# Autodesk Inventor assembly: ASSEMBLY_DUT_Ant_Rotator
(part 3 of 3)
- Mate:295: 3DP_PLA_Fiberglass_Pipe_Corner_Bracket_Clamp:3 ↔ COTS_DREMEC_8G206M6X50_M6x50_Nylon_Screw:20
- Mate:296: 3DP_PLA_Fiberglass_Pipe_Corner_Bracket_Clamp:3 ↔ COTS_DREMEC_8G206M6X50_M6x50_Nylon_Screw:19
- Mate:297: 3DP_PLA_Fiberglass_Pipe_Corner_Bracket_Clamp:3 ↔ COTS_DREMEC_8G206M6X50_M6x50_Nylon_Screw:23
- Mate:298: 3DP_PLA_Fiberglass_Pipe_Corner_Bracket_Clamp:3 ↔ COTS_DREMEC_8G206M6X50_M6x50_Nylon_Screw:21
- Mate:299: 3DP_PLA_Fiberglass_Pipe_Corner_Bracket_Clamp:3 ↔ COTS_DREMEC_8G206M6X50_M6x50_Nylon_Screw:24
- Mate:300: 3DP_PLA_Fiberglass_Pipe_Corner_Bracket_Clamp:2 ↔ COTS_DREMEC_8G206M6X50_M6x50_Nylon_Screw:17
- Mate:301: 3DP_PLA_Fiberglass_Pipe_Corner_Bracket_Clamp:2 ↔ COTS_DREMEC_8G206M6X50_M6x50_Nylon_Screw:18
- Mate:302: 3DP_PLA_Fiberglass_Pipe_Corner_Bracket_Clamp:2 ↔ COTS_DREMEC_8G206M6X50_M6x50_Nylon_Screw:16
- Mate:303: 3DP_PLA_Fiberglass_Pipe_Corner_Bracket_Clamp:2 ↔ COTS_DREMEC_8G206M6X50_M6x50_Nylon_Screw:14
- Mate:304: 3DP_PLA_Fiberglass_Pipe_Corner_Bracket_Clamp:2 ↔ COTS_DREMEC_8G206M6X50_M6x50_Nylon_Screw:13
- Mate:305: 3DP_PLA_Fiberglass_Pipe_Corner_Bracket_Clamp:2 ↔ COTS_DREMEC_8G206M6X50_M6x50_Nylon_Screw:15
- Mate:306: 3DP_PLA_Fiberglass_Pipe_Corner_Bracket:2 ↔ COTS_BOSSARD_1400444_M6_Nylon_Nut:13
- Mate:307: 3DP_PLA_Fiberglass_Pipe_Corner_Bracket:2 ↔ COTS_BOSSARD_1400444_M6_Nylon_Nut:14
- Mate:308: 3DP_PLA_Fiberglass_Pipe_Corner_Bracket:2 ↔ COTS_BOSSARD_1400444_M6_Nylon_Nut:18
- Mate:309: 3DP_PLA_Fiberglass_Pipe_Corner_Bracket:2 ↔ COTS_BOSSARD_1400444_M6_Nylon_Nut:16
- Mate:310: 3DP_PLA_Fiberglass_Pipe_Corner_Bracket:2 ↔ COTS_BOSSARD_1400444_M6_Nylon_Nut:17
- Mate:311: 3DP_PLA_Fiberglass_Pipe_Corner_Bracket:2 ↔ COTS_BOSSARD_1400444_M6_Nylon_Nut:15
- Mate:312: 3DP_PLA_Fiberglass_Pipe_Corner_Bracket:2 ↔ COTS_BOSSARD_1400444_M6_Nylon_Nut:19
- Mate:313: 3DP_PLA_Fiberglass_Pipe_Corner_Bracket:2 ↔ COTS_BOSSARD_1400444_M6_Nylon_Nut:20
- Mate:314: 3DP_PLA_Fiberglass_Pipe_Corner_Bracket:2 ↔ COTS_BOSSARD_1400444_M6_Nylon_Nut:21
- Mate:315: 3DP_PLA_Fiberglass_Pipe_Corner_Bracket:2 ↔ COTS_BOSSARD_1400444_M6_Nylon_Nut:22
- Mate:316: 3DP_PLA_Fiberglass_Pipe_Corner_Bracket:2 ↔ COTS_BOSSARD_1400444_M6_Nylon_Nut:23
- Mate:317: 3DP_PLA_Fiberglass_Pipe_Corner_Bracket:2 ↔ COTS_BOSSARD_1400444_M6_Nylon_Nut:24
- Mate:318: COTS_BOSSARD_1400444_M6_Nylon_Nut:14 ↔ COTS_DREMEC_8G206M6X50_M6x50_Nylon_Screw:17
- Mate:319: COTS_BOSSARD_1400444_M6_Nylon_Nut:13 ↔ COTS_DREMEC_8G206M6X50_M6x50_Nylon_Screw:15
- Mate:320: COTS_BOSSARD_1400444_M6_Nylon_Nut:15 ↔ COTS_DREMEC_8G206M6X50_M6x50_Nylon_Screw:18
- Mate:321: COTS_BOSSARD_1400444_M6_Nylon_Nut:18 ↔ COTS_DREMEC_8G206M6X50_M6x50_Nylon_Screw:16
- Mate:322: COTS_BOSSARD_1400444_M6_Nylon_Nut:17 ↔ COTS_DREMEC_8G206M6X50_M6x50_Nylon_Screw:14
- Mate:323: COTS_BOSSARD_1400444_M6_Nylon_Nut:16 ↔ COTS_DREMEC_8G206M6X50_M6x50_Nylon_Screw:13
- Mate:324: COTS_BOSSARD_1400444_M6_Nylon_Nut:19 ↔ COTS_DREMEC_8G206M6X50_M6x50_Nylon_Screw:24
- Mate:325: COTS_BOSSARD_1400444_M6_Nylon_Nut:20 ↔ COTS_DREMEC_8G206M6X50_M6x50_Nylon_Screw:19
- Mate:326: COTS_BOSSARD_1400444_M6_Nylon_Nut:22 ↔ COTS_DREMEC_8G206M6X50_M6x50_Nylon_Screw:20
- Mate:327: COTS_BOSSARD_1400444_M6_Nylon_Nut:21 ↔ COTS_DREMEC_8G206M6X50_M6x50_Nylon_Screw:23
- Mate:328: COTS_BOSSARD_1400444_M6_Nylon_Nut:24 ↔ COTS_DREMEC_8G206M6X50_M6x50_Nylon_Screw:21
- Mate:329: COTS_BOSSARD_1400444_M6_Nylon_Nut:23 ↔ COTS_DREMEC_8G206M6X50_M6x50_Nylon_Screw:22
- Mate:331: 3DP_PLA_Fiberglass_Pipe_Corner_Bracket_Clamp_and_B_axis_Stepper_Mount:1 ↔ ASSEMBLY_HTD3M_Idler_B_Axis:1
- Mate:332: 3DP_PLA_Fiberglass_Pipe_Corner_Bracket_Clamp_and_B_axis_Stepper_Mount:1 ↔ ASSEMBLY_HTD3M_Idler_B_Axis:2
- Mate:333: 3DP_PLA_Fiberglass_Pipe_Corner_Bracket_Clamp_and_B_axis_Stepper_Mount:1 ↔ ASSEMBLY_HTD3M_Idler_B_Axis:2
- Mate:334: 3DP_PLA_Fiberglass_Pipe_Corner_Bracket_Clamp_and_B_axis_Stepper_Mount:1 ↔ ASSEMBLY_HTD3M_Idler_B_Axis:1
- Mate:335: COTS_GENERIC_HTD3M_20T_6mm_5mm_shaft_pulley:1 ↔ COTS_GENERIC_HTD3M_6mm_1530mm_Closed_belt_B_Axis:1
- Mate:336 (6 mm): 3DP_PLA_Fiberglass_Pipe_Corner_Bracket_Clamp_and_B_axis_Stepper_Mount:1 ↔ COTS_MKS_SERVO42D_40mm:2
- Mate:337 (0.5 mm): COTS_GENERIC_HTD3M_20T_6mm_5mm_shaft_pulley:1 ↔ COTS_GENERIC_HTD3M_6mm_1530mm_Closed_belt_B_Axis:1
- Mate:339: 3DP_PLA_B_Axis_Main_Pulley:1 ↔ COTS_GENERIC_HTD3M_6mm_1530mm_Closed_belt_B_Axis:1
- Mate:340 (0.5 mm): 3DP_PLA_B_Axis_Main_Pulley:1 ↔ COTS_GENERIC_HTD3M_6mm_1530mm_Closed_belt_B_Axis:1
- Mate:341: COTS_MKS_SERVO42D_40mm:2 ↔ DIN 125-1 A A 3,2:5
- Mate:342: 3DP_PLA_Fiberglass_Pipe_Corner_Bracket_Clamp_and_B_axis_Stepper_Mount:1 ↔ DIN 125-1 A A 3,2:5
- Mate:343: COTS_MKS_SERVO42D_40mm:2 ↔ DIN 125-1 A A 3,2:6
- Mate:344: 3DP_PLA_Fiberglass_Pipe_Corner_Bracket_Clamp_and_B_axis_Stepper_Mount:1 ↔ DIN 125-1 A A 3,2:6
- Mate:345: COTS_MKS_SERVO42D_40mm:2 ↔ DIN 125-1 A A 3,2:7
- Mate:346: 3DP_PLA_Fiberglass_Pipe_Corner_Bracket_Clamp_and_B_axis_Stepper_Mount:1 ↔ DIN 125-1 A A 3,2:7
- Mate:347: COTS_MKS_SERVO42D_40mm:2 ↔ DIN 125-1 A A 3,2:8
- Mate:348: 3DP_PLA_Fiberglass_Pipe_Corner_Bracket_Clamp_and_B_axis_Stepper_Mount:1 ↔ DIN 125-1 A A 3,2:8
- Insert:5: ISO 7380-1 M3 x 16:5 ↔ DIN 125-1 A A 3,2:5
- Insert:6: ISO 7380-1 M3 x 16:6 ↔ DIN 125-1 A A 3,2:6
- Insert:7: ISO 7380-1 M3 x 16:7 ↔ DIN 125-1 A A 3,2:7
- Insert:8: ISO 7380-1 M3 x 16:8 ↔ DIN 125-1 A A 3,2:8
- Angle:42 (90 deg): COTS_CARBONCENTER_Fiberglass_Tube_27x24x383mm:3 ↔ COTS_GENERIC_HTD3M_6mm_1530mm_Closed_belt_B_Axis:1
- Mate:357: 3DP_PLA_B_Axis_Main_Pulley:1 ↔ COTS_GENERIC_6016_80x125x22mm_POM_Ball_Bearing:1
- Mate:358: 3DP_PLA_B_Axis_Main_Pulley:1 ↔ COTS_GENERIC_6016_80x125x22mm_POM_Ball_Bearing:1
- Mate:359: 3DP_PLA_B_Axis_Main_Pulley:1 ↔ COTS_GENERIC_6016_80x125x22mm_POM_Ball_Bearing:2
- Mate:360: 3DP_PLA_B_Axis_Main_Pulley:1 ↔ COTS_GENERIC_6016_80x125x22mm_POM_Ball_Bearing:2
- Mate:361: COTS_GENERIC_6016_80x125x22mm_POM_Ball_Bearing:2 ↔ 3DP_PLA_B_Axis_Bearing_Mounting_Plate:1
- Flush:16: COTS_GENERIC_6016_80x125x22mm_POM_Ball_Bearing:2 ↔ 3DP_PLA_B_Axis_Bearing_Mounting_Plate:1
- Angle:43 (0 deg): 3DP_PLA_Fiberglass_Pipe_Corner_Bracket_Clamp_and_B_axis_Stepper_Mount:1 ↔ 3DP_PLA_B_Axis_Bearing_Mounting_Plate:1
- Flush:17: COTS_GENERIC_6016_80x125x22mm_POM_Ball_Bearing:1 ↔ 3DP_PLA_B_Axis_Bearing_Mounting_Plate:2
- Mate:362: COTS_GENERIC_6016_80x125x22mm_POM_Ball_Bearing:1 ↔ 3DP_PLA_B_Axis_Bearing_Mounting_Plate:2
- Flush:18: 3DP_PLA_B_Axis_Bearing_Mounting_Plate:1 ↔ 3DP_PLA_B_Axis_Bearing_Mounting_Plate:2
- Mate:363: 3DP_PLA_B_Axis_Bearing_Mounting_Plate:1 ↔ ASSEMBLY_HTD3M_Idler_B_Axis_Top:1
- Mate:364: 3DP_PLA_B_Axis_Bearing_Mounting_Plate:1 ↔ ASSEMBLY_HTD3M_Idler_B_Axis_Top:2
- Mate:365: 3DP_PLA_B_Axis_Bearing_Mounting_Plate:1 ↔ ASSEMBLY_HTD3M_Idler_B_Axis_Top:1
- Mate:366: 3DP_PLA_B_Axis_Bearing_Mounting_Plate:1 ↔ ASSEMBLY_HTD3M_Idler_B_Axis_Top:2
- Mate:367: 3DP_PLA_B_Axis_Bearing_Mounting_Plate:1 ↔ COTS_DREMEC_8G206V50126_M4x40_Screw:1
- Mate:368: 3DP_PLA_B_Axis_Bearing_Mounting_Plate:1 ↔ COTS_DREMEC_8G206V50126_M4x40_Screw:2
- Mate:369: 3DP_PLA_B_Axis_Bearing_Mounting_Plate:1 ↔ COTS_DREMEC_8G206V50126_M4x40_Screw:2
- Mate:370: 3DP_PLA_B_Axis_Bearing_Mounting_Plate:1 ↔ COTS_DREMEC_8G206V50126_M4x40_Screw:1
- Mate:371: 3DP_PLA_B_Axis_Bearing_Mounting_Plate:2 ↔ COTS_DREMEC_8G206M6X50_M6x50_Nylon_Screw:25
- Mate:372: 3DP_PLA_B_Axis_Bearing_Mounting_Plate:2 ↔ COTS_DREMEC_8G206M6X50_M6x50_Nylon_Screw:26
- Mate:373: 3DP_PLA_B_Axis_Bearing_Mounting_Plate:2 ↔ COTS_DREMEC_8G206M6X50_M6x50_Nylon_Screw:27
- Mate:374: 3DP_PLA_B_Axis_Bearing_Mounting_Plate:2 ↔ COTS_DREMEC_8G206M6X50_M6x50_Nylon_Screw:28
- Mate:375: 3DP_PLA_B_Axis_Bearing_Mounting_Plate:2 ↔ COTS_DREMEC_8G206M6X50_M6x50_Nylon_Screw:29
- Mate:376: 3DP_PLA_B_Axis_Bearing_Mounting_Plate:2 ↔ COTS_DREMEC_8G206M6X50_M6x50_Nylon_Screw:30
- Mate:377: 3DP_PLA_B_Axis_Bearing_Mounting_Plate:2 ↔ COTS_DREMEC_8G206M6X50_M6x50_Nylon_Screw:26
- Mate:378: 3DP_PLA_B_Axis_Bearing_Mounting_Plate:2 ↔ COTS_DREMEC_8G206M6X50_M6x50_Nylon_Screw:28
- Mate:379: 3DP_PLA_B_Axis_Bearing_Mounting_Plate:2 ↔ COTS_DREMEC_8G206M6X50_M6x50_Nylon_Screw:30
- Mate:380: 3DP_PLA_B_Axis_Bearing_Mounting_Plate:2 ↔ COTS_DREMEC_8G206M6X50_M6x50_Nylon_Screw:27
- Mate:381: 3DP_PLA_B_Axis_Bearing_Mounting_Plate:2 ↔ COTS_DREMEC_8G206M6X50_M6x50_Nylon_Screw:25
- Mate:382: 3DP_PLA_B_Axis_Bearing_Mounting_Plate:2 ↔ COTS_DREMEC_8G206M6X50_M6x50_Nylon_Screw:29
- Mate:383: 3DP_PLA_B_Axis_Bearing_Mounting_Plate:1 ↔ COTS_BOSSARD_1400444_M6_Nylon_Nut:25
- Mate:384: 3DP_PLA_B_Axis_Bearing_Mounting_Plate:1 ↔ COTS_BOSSARD_1400444_M6_Nylon_Nut:27
- Mate:385: 3DP_PLA_B_Axis_Bearing_Mounting_Plate:1 ↔ COTS_BOSSARD_1400444_M6_Nylon_Nut:29
- Mate:386: 3DP_PLA_B_Axis_Bearing_Mounting_Plate:1 ↔ COTS_BOSSARD_1400444_M6_Nylon_Nut:30
- Mate:387: 3DP_PLA_B_Axis_Bearing_Mounting_Plate:1 ↔ COTS_BOSSARD_1400444_M6_Nylon_Nut:28
- Mate:388: 3DP_PLA_B_Axis_Bearing_Mounting_Plate:1 ↔ COTS_BOSSARD_1400444_M6_Nylon_Nut:26
- Mate:389: COTS_BOSSARD_1400444_M6_Nylon_Nut:25 ↔ COTS_DREMEC_8G206M6X50_M6x50_Nylon_Screw:28
- Mate:390: COTS_BOSSARD_1400444_M6_Nylon_Nut:28 ↔ COTS_DREMEC_8G206M6X50_M6x50_Nylon_Screw:26
- Mate:391: COTS_BOSSARD_1400444_M6_Nylon_Nut:27 ↔ COTS_DREMEC_8G206M6X50_M6x50_Nylon_Screw:27
- Mate:392: COTS_BOSSARD_1400444_M6_Nylon_Nut:30 ↔ COTS_DREMEC_8G206M6X50_M6x50_Nylon_Screw:30
- Mate:393: COTS_BOSSARD_1400444_M6_Nylon_Nut:29 ↔ COTS_DREMEC_8G206M6X50_M6x50_Nylon_Screw:25
- Mate:394: COTS_BOSSARD_1400444_M6_Nylon_Nut:26 ↔ COTS_DREMEC_8G206M6X50_M6x50_Nylon_Screw:29
- Mate:395: 3DP_PLA_B_Axis_Bearing_Mounting_Plate:2 ↔ COTS_DREMEC_8G206M6X50_M6x50_Nylon_Screw:31
- Mate:396: 3DP_PLA_B_Axis_Bearing_Mounting_Plate:2 ↔ COTS_DREMEC_8G206M6X50_M6x50_Nylon_Screw:31
- Mate:397: 3DP_PLA_B_Axis_Bearing_Mounting_Plate:1 ↔ COTS_BOSSARD_1400444_M6_Nylon_Nut:31
- Mate:398: COTS_BOSSARD_1400444_M6_Nylon_Nut:31 ↔ COTS_DREMEC_8G206M6X50_M6x50_Nylon_Screw:31
- Mate:399: 3DP_PLA_B_Axis_Bearing_Mounting_Plate:2 ↔ COTS_BOSSARD_1400428_M4_Nylon_Nut:1
- Mate:400: 3DP_PLA_B_Axis_Bearing_Mounting_Plate:2 ↔ COTS_BOSSARD_1400428_M4_Nylon_Nut:2
- Mate:401: COTS_BOSSARD_1400428_M4_Nylon_Nut:1 ↔ COTS_DREMEC_8G206V50126_M4x40_Screw:1
- Mate:402: COTS_BOSSARD_1400428_M4_Nylon_Nut:2 ↔ COTS_DREMEC_8G206V50126_M4x40_Screw:2
- Mate:403: COTS_GENERIC_6016_80x125x22mm_POM_Ball_Bearing:2 ↔ 3DP_PLA_B_Axis_Rotating_Stage:1
- Mate:404: 3DP_PLA_B_Axis_Main_Pulley:1 ↔ 3DP_PLA_B_Axis_Rotating_Stage:1
- Mate:405: COTS_CARBONCENTER_Fiberglass_Tube_27x24x383mm:6 ↔ 3DP_PLA_B_Axis_Rotating_Stage:1
- Mate:406: COTS_CARBONCENTER_Fiberglass_Tube_27x24x383mm:5 ↔ 3DP_PLA_B_Axis_Rotating_Stage:1
- Flush:19: COTS_CARBONCENTER_Fiberglass_Tube_27x24x383mm:5 ↔ 3DP_PLA_B_Axis_Rotating_Stage:1
- Mate:407: COTS_CARBONCENTER_Fiberglass_Tube_27x24x383mm:5 ↔ 3DP_PLA_B_Axis_Rotating_Stage_Fiberglass_pipes_mount_clamp:1
- Mate:408: COTS_CARBONCENTER_Fiberglass_Tube_27x24x383mm:6 ↔ 3DP_PLA_B_Axis_Rotating_Stage_Fiberglass_pipes_mount_clamp:1
- Flush:20: 3DP_PLA_B_Axis_Rotating_Stage:1 ↔ 3DP_PLA_B_Axis_Rotating_Stage_Fiberglass_pipes_mount_clamp:1
- Mate:409: COTS_CARBONCENTER_Fiberglass_Tube_27x24x383mm:5 ↔ 3DP_PLA_B_Axis_Rotating_Stage_Fiberglass_pipes_mount_clamp:2
- Mate:410: COTS_CARBONCENTER_Fiberglass_Tube_27x24x383mm:6 ↔ 3DP_PLA_B_Axis_Rotating_Stage_Fiberglass_pipes_mount_clamp:2
- Flush:21: 3DP_PLA_B_Axis_Rotating_Stage:1 ↔ 3DP_PLA_B_Axis_Rotating_Stage_Fiberglass_pipes_mount_clamp:2
- Mate:411: COTS_CARBONCENTER_Fiberglass_Tube_27x24x383mm:4 ↔ 3DP_PLA_B_Axis_Bearing_Mounting_Plate:1
- Mate:412: 3DP_PLA_B_Axis_Rotating_Stage_Fiberglass_pipes_mount_clamp:1 ↔ COTS_DREMEC_8G206M6X50_M6x50_Nylon_Screw:44
- Mate:413: 3DP_PLA_B_Axis_Rotating_Stage_Fiberglass_pipes_mount_clamp:1 ↔ COTS_DREMEC_8G206M6X50_M6x50_Nylon_Screw:43
- Mate:414: 3DP_PLA_B_Axis_Rotating_Stage_Fiberglass_pipes_mount_clamp:1 ↔ COTS_DREMEC_8G206M6X50_M6x50_Nylon_Screw:42
- Mate:415: 3DP_PLA_B_Axis_Rotating_Stage_Fiberglass_pipes_mount_clamp:1 ↔ COTS_DREMEC_8G206M6X50_M6x50_Nylon_Screw:45
- Mate:416: 3DP_PLA_B_Axis_Rotating_Stage_Fiberglass_pipes_mount_clamp:1 ↔ COTS_DREMEC_8G206M6X50_M6x50_Nylon_Screw:46
- Mate:417: 3DP_PLA_B_Axis_Rotating_Stage_Fiberglass_pipes_mount_clamp:1 ↔ COTS_DREMEC_8G206M6X50_M6x50_Nylon_Screw:47
- Mate:418: 3DP_PLA_B_Axis_Rotating_Stage_Fiberglass_pipes_mount_clamp:2 ↔ COTS_DREMEC_8G206M6X50_M6x50_Nylon_Screw:48
- Mate:419: 3DP_PLA_B_Axis_Rotating_Stage_Fiberglass_pipes_mount_clamp:2 ↔ COTS_DREMEC_8G206M6X50_M6x50_Nylon_Screw:49
- Mate:420: 3DP_PLA_B_Axis_Rotating_Stage_Fiberglass_pipes_mount_clamp:2 ↔ COTS_DREMEC_8G206M6X50_M6x50_Nylon_Screw:50
- Mate:421: 3DP_PLA_B_Axis_Rotating_Stage_Fiberglass_pipes_mount_clamp:2 ↔ COTS_DREMEC_8G206M6X50_M6x50_Nylon_Screw:51
- Mate:422: 3DP_PLA_B_Axis_Rotating_Stage_Fiberglass_pipes_mount_clamp:2 ↔ COTS_DREMEC_8G206M6X50_M6x50_Nylon_Screw:52
- Mate:423: 3DP_PLA_B_Axis_Rotating_Stage_Fiberglass_pipes_mount_clamp:2 ↔ COTS_DREMEC_8G206M6X50_M6x50_Nylon_Screw:53
- Mate:424: 3DP_PLA_B_Axis_Rotating_Stage_Fiberglass_pipes_mount_clamp:2 ↔ COTS_DREMEC_8G206M6X50_M6x50_Nylon_Screw:52
- Mate:425: 3DP_PLA_B_Axis_Rotating_Stage_Fiberglass_pipes_mount_clamp:2 ↔ COTS_DREMEC_8G206M6X50_M6x50_Nylon_Screw:50
- Mate:426: 3DP_PLA_B_Axis_Rotating_Stage_Fiberglass_pipes_mount_clamp:2 ↔ COTS_DREMEC_8G206M6X50_M6x50_Nylon_Screw:53
- Mate:427: 3DP_PLA_B_Axis_Rotating_Stage_Fiberglass_pipes_mount_clamp:2 ↔ COTS_DREMEC_8G206M6X50_M6x50_Nylon_Screw:49
- Mate:428: 3DP_PLA_B_Axis_Rotating_Stage_Fiberglass_pipes_mount_clamp:2 ↔ COTS_DREMEC_8G206M6X50_M6x50_Nylon_Screw:48
- Mate:429: 3DP_PLA_B_Axis_Rotating_Stage_Fiberglass_pipes_mount_clamp:2 ↔ COTS_DREMEC_8G206M6X50_M6x50_Nylon_Screw:51
- Mate:430: 3DP_PLA_B_Axis_Rotating_Stage_Fiberglass_pipes_mount_clamp:1 ↔ COTS_DREMEC_8G206M6X50_M6x50_Nylon_Screw:43
- Mate:431: 3DP_PLA_B_Axis_Rotating_Stage_Fiberglass_pipes_mount_clamp:1 ↔ COTS_DREMEC_8G206M6X50_M6x50_Nylon_Screw:42
- Mate:432: 3DP_PLA_B_Axis_Rotating_Stage_Fiberglass_pipes_mount_clamp:1 ↔ COTS_DREMEC_8G206M6X50_M6x50_Nylon_Screw:44
- Mate:433: 3DP_PLA_B_Axis_Rotating_Stage_Fiberglass_pipes_mount_clamp:1 ↔ COTS_DREMEC_8G206M6X50_M6x50_Nylon_Screw:46
- Mate:434: 3DP_PLA_B_Axis_Rotating_Stage_Fiberglass_pipes_mount_clamp:1 ↔ COTS_DREMEC_8G206M6X50_M6x50_Nylon_Screw:47
- Mate:435: 3DP_PLA_B_Axis_Rotating_Stage_Fiberglass_pipes_mount_clamp:1 ↔ COTS_DREMEC_8G206M6X50_M6x50_Nylon_Screw:45
- Mate:436: 3DP_PLA_B_Axis_Rotating_Stage:1 ↔ COTS_BOSSARD_1400444_M6_Nylon_Nut:44
- Mate:437: 3DP_PLA_B_Axis_Rotating_Stage:1 ↔ COTS_BOSSARD_1400444_M6_Nylon_Nut:47
- Mate:438: 3DP_PLA_B_Axis_Rotating_Stage:1 ↔ COTS_BOSSARD_1400444_M6_Nylon_Nut:50
- Mate:439: 3DP_PLA_B_Axis_Rotating_Stage:1 ↔ COTS_BOSSARD_1400444_M6_Nylon_Nut:53
- Mate:440: 3DP_PLA_B_Axis_Rotating_Stage:1 ↔ COTS_BOSSARD_1400444_M6_Nylon_Nut:52
- Mate:441: 3DP_PLA_B_Axis_Rotating_Stage:1 ↔ COTS_BOSSARD_1400444_M6_Nylon_Nut:49
- Mate:442: 3DP_PLA_B_Axis_Rotating_Stage:1 ↔ COTS_BOSSARD_1400444_M6_Nylon_Nut:46
- Mate:443: 3DP_PLA_B_Axis_Rotating_Stage:1 ↔ COTS_BOSSARD_1400444_M6_Nylon_Nut:43
- Mate:444: 3DP_PLA_B_Axis_Rotating_Stage:1 ↔ COTS_BOSSARD_1400444_M6_Nylon_Nut:42
- Mate:445: 3DP_PLA_B_Axis_Rotating_Stage:1 ↔ COTS_BOSSARD_1400444_M6_Nylon_Nut:51
- Mate:446: 3DP_PLA_B_Axis_Rotating_Stage:1 ↔ COTS_BOSSARD_1400444_M6_Nylon_Nut:45
- Mate:447: 3DP_PLA_B_Axis_Rotating_Stage:1 ↔ COTS_BOSSARD_1400444_M6_Nylon_Nut:48
- Mate:448: COTS_BOSSARD_1400444_M6_Nylon_Nut:48 ↔ COTS_DREMEC_8G206M6X50_M6x50_Nylon_Screw:43
- Mate:449: COTS_BOSSARD_1400444_M6_Nylon_Nut:45 ↔ COTS_DREMEC_8G206M6X50_M6x50_Nylon_Screw:47
- Mate:450: COTS_BOSSARD_1400444_M6_Nylon_Nut:51 ↔ COTS_DREMEC_8G206M6X50_M6x50_Nylon_Screw:44
- Mate:451: COTS_BOSSARD_1400444_M6_Nylon_Nut:46 ↔ COTS_DREMEC_8G206M6X50_M6x50_Nylon_Screw:46
- Mate:452: COTS_BOSSARD_1400444_M6_Nylon_Nut:43 ↔ COTS_DREMEC_8G206M6X50_M6x50_Nylon_Screw:45
- Mate:453: COTS_BOSSARD_1400444_M6_Nylon_Nut:42 ↔ COTS_DREMEC_8G206M6X50_M6x50_Nylon_Screw:42
- Mate:454: COTS_BOSSARD_1400444_M6_Nylon_Nut:50 ↔ COTS_DREMEC_8G206M6X50_M6x50_Nylon_Screw:52
- Mate:455: COTS_BOSSARD_1400444_M6_Nylon_Nut:49 ↔ COTS_DREMEC_8G206M6X50_M6x50_Nylon_Screw:50
- Mate:456: COTS_BOSSARD_1400444_M6_Nylon_Nut:47 ↔ COTS_DREMEC_8G206M6X50_M6x50_Nylon_Screw:53
- Mate:457: COTS_BOSSARD_1400444_M6_Nylon_Nut:52 ↔ COTS_DREMEC_8G206M6X50_M6x50_Nylon_Screw:49
- Mate:458: COTS_BOSSARD_1400444_M6_Nylon_Nut:44 ↔ COTS_DREMEC_8G206M6X50_M6x50_Nylon_Screw:48
- Mate:459: COTS_BOSSARD_1400444_M6_Nylon_Nut:53 ↔ COTS_DREMEC_8G206M6X50_M6x50_Nylon_Screw:51
- Angle:44 (0 deg): 3DP_PLA_B_Axis_Rotating_Stage:1 ↔ COTS_BOSSARD_1400444_M6_Nylon_Nut:44
- Angle:45 (0 deg): 3DP_PLA_B_Axis_Rotating_Stage:1 ↔ COTS_BOSSARD_1400444_M6_Nylon_Nut:53
- Angle:46 (0 deg): 3DP_PLA_B_Axis_Rotating_Stage:1 ↔ COTS_BOSSARD_1400444_M6_Nylon_Nut:52
- Angle:47 (0 deg): 3DP_PLA_B_Axis_Rotating_Stage:1 ↔ COTS_BOSSARD_1400444_M6_Nylon_Nut:47
- Angle:48 (0 deg): 3DP_PLA_B_Axis_Rotating_Stage:1 ↔ COTS_BOSSARD_1400444_M6_Nylon_Nut:50
- Angle:49 (0 deg): 3DP_PLA_B_Axis_Rotating_Stage:1 ↔ COTS_BOSSARD_1400444_M6_Nylon_Nut:49
- Angle:50 (0 deg): 3DP_PLA_B_Axis_Rotating_Stage:1 ↔ COTS_BOSSARD_1400444_M6_Nylon_Nut:42
- Angle:51 (0 deg): 3DP_PLA_B_Axis_Rotating_Stage:1 ↔ COTS_BOSSARD_1400444_M6_Nylon_Nut:48
- Angle:52 (0 deg): 3DP_PLA_B_Axis_Rotating_Stage:1 ↔ COTS_BOSSARD_1400444_M6_Nylon_Nut:43
- Angle:53 (0 deg): 3DP_PLA_B_Axis_Rotating_Stage:1 ↔ COTS_BOSSARD_1400444_M6_Nylon_Nut:45
- Angle:54 (-90 deg): 3DP_PLA_Fiberglass_Pipe_Corner_Bracket:2 ↔ 3DP_PLA_B_Axis_Bearing_Mounting_Plate:1
- Mate:460: 3DP_PLA_B_Axis_Main_Pulley:1 ↔ 3DP_PLA_B_Axis_Rotating_Stage:1
- Mate:461: 3DP_PLA_B_Axis_Main_Pulley:1 ↔ COTS_DREMEC_8G206M6X50_M6x50_Nylon_Screw:55
- Mate:462: 3DP_PLA_B_Axis_Main_Pulley:1 ↔ COTS_DREMEC_8G206M6X50_M6x50_Nylon_Screw:54
- Mate:463: 3DP_PLA_B_Axis_Main_Pulley:1 ↔ COTS_DREMEC_8G206M6X50_M6x50_Nylon_Screw:56
- Mate:464: 3DP_PLA_B_Axis_Main_Pulley:1 ↔ COTS_DREMEC_8G206M6X50_M6x50_Nylon_Screw:57
- Mate:465: 3DP_PLA_B_Axis_Main_Pulley:1 ↔ COTS_DREMEC_8G206M6X50_M6x50_Nylon_Screw:59
- Mate:466: 3DP_PLA_B_Axis_Main_Pulley:1 ↔ COTS_DREMEC_8G206M6X50_M6x50_Nylon_Screw:58
- Mate:467: 3DP_PLA_B_Axis_Main_Pulley:1 ↔ COTS_DREMEC_8G206M6X50_M6x50_Nylon_Screw:54
- Mate:468: 3DP_PLA_B_Axis_Main_Pulley:1 ↔ COTS_DREMEC_8G206M6X50_M6x50_Nylon_Screw:56
- Mate:469: 3DP_PLA_B_Axis_Main_Pulley:1 ↔ COTS_DREMEC_8G206M6X50_M6x50_Nylon_Screw:58
- Mate:470: 3DP_PLA_B_Axis_Main_Pulley:1 ↔ COTS_DREMEC_8G206M6X50_M6x50_Nylon_Screw:59
- Mate:471: 3DP_PLA_B_Axis_Main_Pulley:1 ↔ COTS_DREMEC_8G206M6X50_M6x50_Nylon_Screw:57
- Mate:472: 3DP_PLA_B_Axis_Main_Pulley:1 ↔ COTS_DREMEC_8G206M6X50_M6x50_Nylon_Screw:55
- Mate:473: 3DP_PLA_B_Axis_Rotating_Stage:1 ↔ COTS_BOSSARD_1400444_M6_Nylon_Nut:55
- Mate:474: 3DP_PLA_B_Axis_Rotating_Stage:1 ↔ COTS_BOSSARD_1400444_M6_Nylon_Nut:54
- Mate:475: 3DP_PLA_B_Axis_Rotating_Stage:1 ↔ COTS_BOSSARD_1400444_M6_Nylon_Nut:56
- Mate:476: 3DP_PLA_B_Axis_Rotating_Stage:1 ↔ COTS_BOSSARD_1400444_M6_Nylon_Nut:57
- Mate:477: 3DP_PLA_B_Axis_Rotating_Stage:1 ↔ COTS_BOSSARD_1400444_M6_Nylon_Nut:59
- Mate:478: 3DP_PLA_B_Axis_Rotating_Stage:1 ↔ COTS_BOSSARD_1400444_M6_Nylon_Nut:58
- Mate:479: COTS_BOSSARD_1400444_M6_Nylon_Nut:59 ↔ COTS_DREMEC_8G206M6X50_M6x50_Nylon_Screw:55
- Mate:480: COTS_BOSSARD_1400444_M6_Nylon_Nut:58 ↔ COTS_DREMEC_8G206M6X50_M6x50_Nylon_Screw:57
- Mate:481: COTS_BOSSARD_1400444_M6_Nylon_Nut:55 ↔ COTS_DREMEC_8G206M6X50_M6x50_Nylon_Screw:54
- Mate:482: COTS_BOSSARD_1400444_M6_Nylon_Nut:54 ↔ COTS_DREMEC_8G206M6X50_M6x50_Nylon_Screw:56
- Mate:483: COTS_BOSSARD_1400444_M6_Nylon_Nut:56 ↔ COTS_DREMEC_8G206M6X50_M6x50_Nylon_Screw:58
- Mate:484: COTS_BOSSARD_1400444_M6_Nylon_Nut:57 ↔ COTS_DREMEC_8G206M6X50_M6x50_Nylon_Screw:59
- Angle:55 (0 deg): 3DP_PLA_B_Axis_Rotating_Stage:1 ↔ COTS_BOSSARD_1400444_M6_Nylon_Nut:55
- Angle:56 (0 deg): 3DP_PLA_B_Axis_Rotating_Stage:1 ↔ COTS_BOSSARD_1400444_M6_Nylon_Nut:54
- Angle:57 (0 deg): 3DP_PLA_B_Axis_Rotating_Stage:1 ↔ COTS_BOSSARD_1400444_M6_Nylon_Nut:56
- Angle:58 (0 deg): 3DP_PLA_B_Axis_Rotating_Stage:1 ↔ COTS_BOSSARD_1400444_M6_Nylon_Nut:57
- Angle:59 (0 deg): 3DP_PLA_B_Axis_Rotating_Stage:1 ↔ COTS_BOSSARD_1400444_M6_Nylon_Nut:58
- Angle:60 (0 deg): 3DP_PLA_B_Axis_Rotating_Stage:1 ↔ COTS_BOSSARD_1400444_M6_Nylon_Nut:59
- Mate:485: COTS_GENERIC_6016_80x125x22mm_POM_Ball_Bearing:1 ↔ 3DP_PLA_B_Axis_End_Cap:1
- Mate:486: 3DP_PLA_B_Axis_Main_Pulley:1 ↔ 3DP_PLA_B_Axis_End_Cap:1
- Mate:487: 3DP_PLA_B_Axis_Main_Pulley:1 ↔ 3DP_PLA_B_Axis_End_Cap:1
- Mate:488: 3DP_PLA_B_Axis_Main_Pulley:1 ↔ COTS_DREMEC_8G206M6X50_M6x50_Nylon_Screw:62
- Mate:489: 3DP_PLA_B_Axis_Main_Pulley:1 ↔ COTS_DREMEC_8G206M6X50_M6x50_Nylon_Screw:61
- Mate:490: 3DP_PLA_B_Axis_Main_Pulley:1 ↔ COTS_DREMEC_8G206M6X50_M6x50_Nylon_Screw:60
- Mate:491: 3DP_PLA_B_Axis_Main_Pulley:1 ↔ COTS_DREMEC_8G206M6X50_M6x50_Nylon_Screw:61
- Mate:492: 3DP_PLA_B_Axis_Main_Pulley:1 ↔ COTS_DREMEC_8G206M6X50_M6x50_Nylon_Screw:60
- Mate:493: 3DP_PLA_B_Axis_Main_Pulley:1 ↔ COTS_DREMEC_8G206M6X50_M6x50_Nylon_Screw:62
- Mate:494: 3DP_PLA_B_Axis_End_Cap:1 ↔ COTS_BOSSARD_1400444_M6_Nylon_Nut:61
- Mate:495: 3DP_PLA_B_Axis_End_Cap:1 ↔ COTS_BOSSARD_1400444_M6_Nylon_Nut:62
- Mate:496: 3DP_PLA_B_Axis_End_Cap:1 ↔ COTS_BOSSARD_1400444_M6_Nylon_Nut:60
- Mate:497: COTS_BOSSARD_1400444_M6_Nylon_Nut:60 ↔ COTS_DREMEC_8G206M6X50_M6x50_Nylon_Screw:62
- Mate:498: COTS_BOSSARD_1400444_M6_Nylon_Nut:62 ↔ COTS_DREMEC_8G206M6X50_M6x50_Nylon_Screw:60
- Mate:499: COTS_BOSSARD_1400444_M6_Nylon_Nut:61 ↔ COTS_DREMEC_8G206M6X50_M6x50_Nylon_Screw:61
- Angle:61 (0 deg): 3DP_PLA_B_Axis_End_Cap:1 ↔ COTS_BOSSARD_1400444_M6_Nylon_Nut:61
- Angle:62 (0 deg): 3DP_PLA_B_Axis_End_Cap:1 ↔ COTS_BOSSARD_1400444_M6_Nylon_Nut:62
- Angle:63 (0 deg): 3DP_PLA_B_Axis_End_Cap:1 ↔ COTS_BOSSARD_1400444_M6_Nylon_Nut:60
- Mate:500: COTS_CARBONCENTER_Fiberglass_Tube_27x24x383mm:8 ↔ 3DP_PLA_Antenna_Boom_Coax_Feed_Horn:1
- Mate:501: COTS_CARBONCENTER_Fiberglass_Tube_27x24x383mm:7 ↔ 3DP_PLA_Antenna_Boom_Coax_Feed_Horn:1
- Flush:22 (102.5 mm): COTS_CARBONCENTER_Fiberglass_Tube_27x24x383mm:8 ↔ 3DP_PLA_Antenna_Boom_Coax_Feed_Horn:1
- Mate:502: COTS_CARBONCENTER_Fiberglass_Tube_27x24x383mm:8 ↔ 3DP_PLA_Antenna_Boom_Fiberglass_Pipe_Clamp:1
- Mate:503: COTS_CARBONCENTER_Fiberglass_Tube_27x24x383mm:7 ↔ 3DP_PLA_Antenna_Boom_Fiberglass_Pipe_Clamp:1
- Flush:23: 3DP_PLA_Antenna_Boom_Coax_Feed_Horn:1 ↔ 3DP_PLA_Antenna_Boom_Fiberglass_Pipe_Clamp:1
- Mate:504: 3DP_PLA_Antenna_Boom_Coax_Feed_Horn:1 ↔ COTS_DREMEC_8G206M6X50_M6x50_Nylon_Screw:63
- Mate:505: 3DP_PLA_Antenna_Boom_Coax_Feed_Horn:1 ↔ COTS_DREMEC_8G206M6X50_M6x50_Nylon_Screw:64
- Mate:506: 3DP_PLA_Antenna_Boom_Coax_Feed_Horn:1 ↔ COTS_DREMEC_8G206M6X50_M6x50_Nylon_Screw:65
- Mate:507: 3DP_PLA_Antenna_Boom_Coax_Feed_Horn:1 ↔ COTS_DREMEC_8G206M6X50_M6x50_Nylon_Screw:66
- Mate:508: 3DP_PLA_Antenna_Boom_Coax_Feed_Horn:1 ↔ COTS_DREMEC_8G206M6X50_M6x50_Nylon_Screw:66
- Mate:509: 3DP_PLA_Antenna_Boom_Coax_Feed_Horn:1 ↔ COTS_DREMEC_8G206M6X50_M6x50_Nylon_Screw:64
- Mate:510: 3DP_PLA_Antenna_Boom_Coax_Feed_Horn:1 ↔ COTS_DREMEC_8G206M6X50_M6x50_Nylon_Screw:63
- Mate:511: 3DP_PLA_Antenna_Boom_Coax_Feed_Horn:1 ↔ COTS_DREMEC_8G206M6X50_M6x50_Nylon_Screw:65
- Mate:512: 3DP_PLA_Antenna_Boom_Fiberglass_Pipe_Clamp:1 ↔ COTS_BOSSARD_1400444_M6_Nylon_Nut:63
- Mate:513: 3DP_PLA_Antenna_Boom_Fiberglass_Pipe_Clamp:1 ↔ COTS_BOSSARD_1400444_M6_Nylon_Nut:66
- Mate:514: 3DP_PLA_Antenna_Boom_Fiberglass_Pipe_Clamp:1 ↔ COTS_BOSSARD_1400444_M6_Nylon_Nut:65
- Mate:515: 3DP_PLA_Antenna_Boom_Fiberglass_Pipe_Clamp:1 ↔ COTS_BOSSARD_1400444_M6_Nylon_Nut:64
- Mate:516: COTS_BOSSARD_1400444_M6_Nylon_Nut:64 ↔ COTS_DREMEC_8G206M6X50_M6x50_Nylon_Screw:66
- Mate:517: COTS_BOSSARD_1400444_M6_Nylon_Nut:66 ↔ COTS_DREMEC_8G206M6X50_M6x50_Nylon_Screw:64
- Mate:518: COTS_BOSSARD_1400444_M6_Nylon_Nut:63 ↔ COTS_DREMEC_8G206M6X50_M6x50_Nylon_Screw:63
- Mate:519: COTS_BOSSARD_1400444_M6_Nylon_Nut:65 ↔ COTS_DREMEC_8G206M6X50_M6x50_Nylon_Screw:65
- Mate:520: COTS_BYTECHLAB_Coaxial_Feed_Horn:1 ↔ 3DP_PLA_Antenna_Boom_Coax_Feed_Horn:1
- Mate:521: COTS_BYTECHLAB_Coaxial_Feed_Horn:1 ↔ 3DP_PLA_Antenna_Boom_Coax_Feed_Horn:1
- Mate:522: COTS_BYTECHLAB_Coaxial_Feed_Horn:1 ↔ 3DP_PLA_Antenna_Boom_Coax_Feed_Horn:1
- Mate:523: 3DP_PLA_A_Axis_Bearing_Base:1 ↔ 3DP_PLA_A_Axis_Bearing_Base_Tripod_Mount:1
- Mate:524: 3DP_PLA_A_Axis_Bearing_Base:1 ↔ 3DP_PLA_A_Axis_Bearing_Base_Tripod_Mount:1
- Mate:525: 3DP_PLA_A_Axis_Bearing_Base:1 ↔ 3DP_PLA_A_Axis_Bearing_Base_Tripod_Mount:1
- Mate:526: COTS_GlareOne_A-275_Tripod:1 ↔ 3DP_PLA_A_Axis_Bearing_Base_Tripod_Mount:1
- Mate:527: COTS_GlareOne_A-275_Tripod:1 ↔ 3DP_PLA_A_Axis_Bearing_Base_Tripod_Mount:1
- Mate:528: 3DP_PLA_A_Axis_Bearing_Base_Tripod_Mount:1 ↔ DIN 912 - replaced by DIN EN ISO 4762 M5 x 30:1
- Mate:529: 3DP_PLA_A_Axis_Bearing_Base_Tripod_Mount:1 ↔ DIN 912 - replaced by DIN EN ISO 4762 M5 x 30:1
- Mate:530: 3DP_PLA_A_Axis_Bearing_Base:1 ↔ DIN 912 - replaced by DIN EN ISO 4762 M5 x 30:2
- Mate:531: 3DP_PLA_A_Axis_Bearing_Base_Tripod_Mount:1 ↔ DIN 912 - replaced by DIN EN ISO 4762 M5 x 30:2
- Mate:532: 3DP_PLA_A_Axis_Bearing_Base:1 ↔ DIN 912 - replaced by DIN EN ISO 4762 M5 x 30:3
- Mate:533: 3DP_PLA_A_Axis_Bearing_Base_Tripod_Mount:1 ↔ DIN 912 - replaced by DIN EN ISO 4762 M5 x 30:3
- Mate:534: 3DP_PLA_A_Axis_Bearing_Base:1 ↔ DIN 912 - replaced by DIN EN ISO 4762 M5 x 30:4
- Mate:535: 3DP_PLA_A_Axis_Bearing_Base_Tripod_Mount:1 ↔ DIN 912 - replaced by DIN EN ISO 4762 M5 x 30:4
- Mate:536: 3DP_PLA_A_Axis_Bearing_Base:1 ↔ DIN 912 - replaced by DIN EN ISO 4762 M5 x 30:5
- Mate:537: 3DP_PLA_A_Axis_Bearing_Base_Tripod_Mount:1 ↔ DIN 912 - replaced by DIN EN ISO 4762 M5 x 30:5
- Mate:538: 3DP_PLA_A_Axis_Bearing_Base:1 ↔ DIN 912 - replaced by DIN EN ISO 4762 M5 x 30:6
- Mate:539: 3DP_PLA_A_Axis_Bearing_Base_Tripod_Mount:1 ↔ DIN 912 - replaced by DIN EN ISO 4762 M5 x 30:6
- Mate:540: 3DP_PLA_A_Axis_Bearing_Base:1 ↔ DIN 912 - replaced by DIN EN ISO 4762 M5 x 30:7
- Mate:541: 3DP_PLA_A_Axis_Bearing_Base_Tripod_Mount:1 ↔ DIN 912 - replaced by DIN EN ISO 4762 M5 x 30:7
- Mate:542: 3DP_PLA_A_Axis_Bearing_Base_Tripod_Mount:1 ↔ DIN 934 - replaced by DIN EN 24032/28673/28674 M5:21
- Mate:543: 3DP_PLA_A_Axis_Bearing_Base:1 ↔ DIN 934 - replaced by DIN EN 24032/28673/28674 M5:21
- Mate:544: 3DP_PLA_A_Axis_Bearing_Base:1 ↔ DIN 934 - replaced by DIN EN 24032/28673/28674 M5:22
- Mate:545: 3DP_PLA_A_Axis_Bearing_Base:1 ↔ DIN 934 - replaced by DIN EN 24032/28673/28674 M5:22
- Mate:546: 3DP_PLA_A_Axis_Bearing_Base:1 ↔ DIN 934 - replaced by DIN EN 24032/28673/28674 M5:23
- Mate:547: 3DP_PLA_A_Axis_Bearing_Base:1 ↔ DIN 934 - replaced by DIN EN 24032/28673/28674 M5:23
- Mate:548: 3DP_PLA_A_Axis_Bearing_Base:1 ↔ DIN 934 - replaced by DIN EN 24032/28673/28674 M5:24
- Mate:549: 3DP_PLA_A_Axis_Bearing_Base:1 ↔ DIN 934 - replaced by DIN EN 24032/28673/28674 M5:24
- Mate:550: 3DP_PLA_A_Axis_Bearing_Base:1 ↔ DIN 934 - replaced by DIN EN 24032/28673/28674 M5:25
- Mate:551: 3DP_PLA_A_Axis_Bearing_Base:1 ↔ DIN 934 - replaced by DIN EN 24032/28673/28674 M5:25
- Mate:552: 3DP_PLA_A_Axis_Bearing_Base:1 ↔ DIN 934 - replaced by DIN EN 24032/28673/28674 M5:26
- Mate:553: 3DP_PLA_A_Axis_Bearing_Base:1 ↔ DIN 934 - replaced by DIN EN 24032/28673/28674 M5:26
- Mate:554: 3DP_PLA_A_Axis_Bearing_Base:1 ↔ DIN 934 - replaced by DIN EN 24032/28673/28674 M5:27
- Mate:555: 3DP_PLA_A_Axis_Bearing_Base:1 ↔ DIN 934 - replaced by DIN EN 24032/28673/28674 M5:27
- Mate:556: 3DP_PLA_A_Axis_Bearing_Base_Tripod_Mount:1 ↔ COTS_BOSSARD_1386786_M5_Threaded_Insert:1
- Mate:557: 3DP_PLA_A_Axis_Bearing_Base_Tripod_Mount:1 ↔ COTS_BOSSARD_1386786_M5_Threaded_Insert:1
- Mate:558: DIN 912 - replaced by DIN EN ISO 4762 M5 x 20:1 ↔ COTS_BOSSARD_1386786_M5_Threaded_Insert:1
- Mate:559 (6.5 mm): DIN 912 - replaced by DIN EN ISO 4762 M5 x 20:1 ↔ COTS_BOSSARD_1386786_M5_Threaded_Insert:1
- Mate:560: COTS_GlareOne_A-275_Tripod:1 ↔ COTS_PROFOTO_Tripod_Sandbag:1
- Mate:561: COTS_GlareOne_A-275_Tripod:1 ↔ COTS_PROFOTO_Tripod_Sandbag:1
- Mate:562: COTS_GlareOne_A-275_Tripod:1 ↔ COTS_PROFOTO_Tripod_Sandbag:1
- Mate:563: 3DP_PLA_A_Axis_Stepper_Mount:1 ↔ COTS_MKS_Cacable_1_0_PRO:1
- Mate:564: 3DP_PLA_A_Axis_Stepper_Mount:1 ↔ COTS_MKS_Cacable_1_0_PRO:1
- Mate:565: 3DP_PLA_A_Axis_Stepper_Mount:1 ↔ COTS_MKS_Cacable_1_0_PRO:1
- Mate:574: 3DP_PLA_A_Axis_Stepper_Mount:1 ↔ COTS_GENERIC_5.6mm_DC_Jack:1
- Mate:575: 3DP_PLA_A_Axis_Stepper_Mount:1 ↔ COTS_GENERIC_5.6mm_DC_Jack:1
- Mate:576: 3DP_PLA_A_Axis_Bearing_Base:1 ↔ COTS_Profihot_HC-2-22x16_Zip_Tie_Anchor:1
- Angle:64 (0 deg): 3DP_PLA_A_Axis_Bearing_Base:1 ↔ COTS_Profihot_HC-2-22x16_Zip_Tie_Anchor:1
- Mate:577: 3DP_PLA_A_Axis_Bearing_Base:1 ↔ COTS_BOSSARD_1386883_M4_Threaded_Insert:1
- Flush:24: 3DP_PLA_A_Axis_Bearing_Base:1 ↔ COTS_BOSSARD_1386883_M4_Threaded_Insert:1
- Mate:578: COTS_Profihot_HC-2-22x16_Zip_Tie_Anchor:1 ↔ COTS_BOSSARD_1386883_M4_Threaded_Insert:1
- Mate:579: COTS_Profihot_HC-2-22x16_Zip_Tie_Anchor:1 ↔ DIN 125-1 A A 4,3:1
- Mate:580: COTS_Profihot_HC-2-22x16_Zip_Tie_Anchor:1 ↔ DIN 125-1 A A 4,3:1
- Insert:9: DIN 125-1 A A 4,3:1 ↔ ISO 7380-1 M4 x 8:1
- Mate:581: 3DP_PLA_Fiberglass_Pipe_Corner_Bracket_Clamp_and_B_axis_Stepper_Mount:1 ↔ COTS_Profihot_HC-2-22x16_Zip_Tie_Anchor:2
- Angle:65 (0 deg): COTS_MKS_SERVO42D_40mm:2 ↔ COTS_Profihot_HC-2-22x16_Zip_Tie_Anchor:2
- Mate:582: 3DP_PLA_Fiberglass_Pipe_Corner_Bracket_Clamp_and_B_axis_Stepper_Mount:1 ↔ DIN 125-1 A A 4,3:2
- Mate:583: COTS_Profihot_HC-2-22x16_Zip_Tie_Anchor:2 ↔ DIN 125-1 A A 4,3:2
- Insert:10: DIN 125-1 A A 4,3:2 ↔ ISO 7380-1 M4 x 16:1
- Mate:584: 3DP_PLA_Fiberglass_Pipe_Corner_Bracket_Clamp_and_B_axis_Stepper_Mount:1 ↔ DIN 125-1 A A 4,3:3
- Mate:585: 3DP_PLA_Fiberglass_Pipe_Corner_Bracket_Clamp_and_B_axis_Stepper_Mount:1 ↔ DIN 125-1 A A 4,3:3
- Insert:11: DIN 125-1 A A 4,3:3 ↔ DIN 934 - replaced by DIN EN 24032/28673/28674 M4:24
- Mate:586: 3DP_PLA_B_Axis_Bearing_Mounting_Plate:2 ↔ COTS_Profihot_HC-2-22x16_Zip_Tie_Anchor:3
- Angle:66 (0 deg): 3DP_PLA_B_Axis_Bearing_Mounting_Plate:2 ↔ COTS_Profihot_HC-2-22x16_Zip_Tie_Anchor:3
- Mate:587: 3DP_PLA_B_Axis_Bearing_Mounting_Plate:2 ↔ COTS_Profihot_HC-2-22x16_Zip_Tie_Anchor:3
- Mate:588: 3DP_PLA_B_Axis_Bearing_Mounting_Plate:2 ↔ COTS_DREMEC_8G206M5X08_M5x8_Nylon_Screw:1
- Mate:589: COTS_Profihot_HC-2-22x16_Zip_Tie_Anchor:3 ↔ COTS_DREMEC_8G206M5X08_M5x8_Nylon_Screw:1
- Mate:590: COTS_CARBONCENTER_Fiberglass_Tube_27x24x383mm:5 ↔ 3DP_PLA_B_Axis_Cable_Galnd:1
- Mate:591: COTS_CARBONCENTER_Fiberglass_Tube_27x24x383mm:5 ↔ 3DP_PLA_B_Axis_Cable_Galnd:1
- Mate:592: ASSEMBLY_HTD3M_Idler_A_Axis:2 ↔ 3DP_PLA_A_Axis_Idler_Stiffening_Bracket:1
- Mate:593: ASSEMBLY_HTD3M_Idler_A_Axis:2 ↔ 3DP_PLA_A_Axis_Idler_Stiffening_Bracket:1
- Mate:594: ASSEMBLY_HTD3M_Idler_A_Axis:1 ↔ 3DP_PLA_A_Axis_Idler_Stiffening_Bracket:1
- Mate:595: 3DP_PLA_A_Axis_Idler_Stiffening_Bracket:1 ↔ DIN 912 - replaced by DIN EN ISO 4762 M4 x 35:3
- Mate:596: 3DP_PLA_A_Axis_Idler_Stiffening_Bracket:1 ↔ DIN 912 - replaced by DIN EN ISO 4762 M4 x 35:3
- Mate:597: 3DP_PLA_A_Axis_Idler_Stiffening_Bracket:1 ↔ DIN 912 - replaced by DIN EN ISO 4762 M4 x 35:4
- Mate:598: 3DP_PLA_A_Axis_Idler_Stiffening_Bracket:1 ↔ DIN 912 - replaced by DIN EN ISO 4762 M4 x 35:4
- Mate:599: 3DP_PLA_A_Axis_Idler_Stiffening_Bracket:1 ↔ DIN 934 - replaced by DIN EN 24032/28673/28674 M4:25
- Mate:600: 3DP_PLA_A_Axis_Stepper_Mount:1 ↔ DIN 934 - replaced by DIN EN 24032/28673/28674 M4:25
- Mate:601: 3DP_PLA_A_Axis_Idler_Stiffening_Bracket:1 ↔ DIN 934 - replaced by DIN EN 24032/28673/28674 M4:26
- Mate:602: 3DP_PLA_A_Axis_Stepper_Mount:1 ↔ DIN 934 - replaced by DIN EN 24032/28673/28674 M4:26
- Mate:603: ASSEMBLY_HTD3M_Idler_B_Axis:2 ↔ 3DP_PLA_B_Axis_Idler_Stiffening_Bracket:1
- Mate:604: ASSEMBLY_HTD3M_Idler_B_Axis:2 ↔ 3DP_PLA_B_Axis_Idler_Stiffening_Bracket:1
- Mate:605: ASSEMBLY_HTD3M_Idler_B_Axis:1 ↔ 3DP_PLA_B_Axis_Idler_Stiffening_Bracket:1
- Mate:606: 3DP_PLA_B_Axis_Idler_Stiffening_Bracket:1 ↔ ISO 7380-1 M4 x 40:12
- Mate:607: 3DP_PLA_B_Axis_Idler_Stiffening_Bracket:1 ↔ ISO 7380-1 M4 x 40:12
- Mate:608: 3DP_PLA_B_Axis_Idler_Stiffening_Bracket:1 ↔ ISO 7380-1 M4 x 40:13
- Mate:609: 3DP_PLA_B_Axis_Idler_Stiffening_Bracket:1 ↔ ISO 7380-1 M4 x 40:13
- Mate:610: 3DP_PLA_B_Axis_Idler_Stiffening_Bracket:1 ↔ DIN 934 - replaced by DIN EN 24032/28673/28674 M4:27
- Mate:611: 3DP_PLA_Fiberglass_Pipe_Corner_Bracket_Clamp_and_B_axis_Stepper_Mount:1 ↔ DIN 934 - replaced by DIN EN 24032/28673/28674 M4:27
- Mate:612: 3DP_PLA_B_Axis_Idler_Stiffening_Bracket:1 ↔ DIN 934 - replaced by DIN EN 24032/28673/28674 M4:28
- Mate:613: 3DP_PLA_Fiberglass_Pipe_Corner_Bracket_Clamp_and_B_axis_Stepper_Mount:1 ↔ DIN 934 - replaced by DIN EN 24032/28673/28674 M4:28
- Angle:67 (0 deg): 3DP_PLA_A_Axis_Bearing_Base:1 ↔ COTS_GlareOne_A-275_Tripod:1
- Mate:614: COTS_MKS_Cacable_1_0_PRO:1 ↔ 3DP_PLA_CANable_Mounting_Plate:1
- Mate:615: COTS_MKS_Cacable_1_0_PRO:1 ↔ 3DP_PLA_CANable_Mounting_Plate:1
- Mate:616: 3DP_PLA_A_Axis_Stepper_Mount:1 ↔ 3DP_PLA_CANable_Mounting_Plate:1
- Mate:617: 3DP_PLA_CANable_Mounting_Plate:1 ↔ DIN 912 - replaced by DIN EN ISO 4762 M2 x 16:1
- Mate:618: 3DP_PLA_CANable_Mounting_Plate:1 ↔ DIN 912 - replaced by DIN EN ISO 4762 M2 x 16:1
- Mate:619: 3DP_PLA_CANable_Mounting_Plate:1 ↔ DIN 912 - replaced by DIN EN ISO 4762 M2 x 16:2
- Mate:620: 3DP_PLA_CANable_Mounting_Plate:1 ↔ DIN 912 - replaced by DIN EN ISO 4762 M2 x 16:2
- Mate:621: 3DP_PLA_CANable_Mounting_Plate:1 ↔ DIN 912 - replaced by DIN EN ISO 4762 M2 x 16:3
- Mate:622: 3DP_PLA_CANable_Mounting_Plate:1 ↔ DIN 912 - replaced by DIN EN ISO 4762 M2 x 16:3
- Mate:623: 3DP_PLA_CANable_Mounting_Plate:1 ↔ DIN 912 - replaced by DIN EN ISO 4762 M2 x 16:4
- Mate:624: 3DP_PLA_CANable_Mounting_Plate:1 ↔ DIN 912 - replaced by DIN EN ISO 4762 M2 x 16:4
